# Autodesk Inventor assembly: RDS-GHN300-0000 Reagent Dosing Station
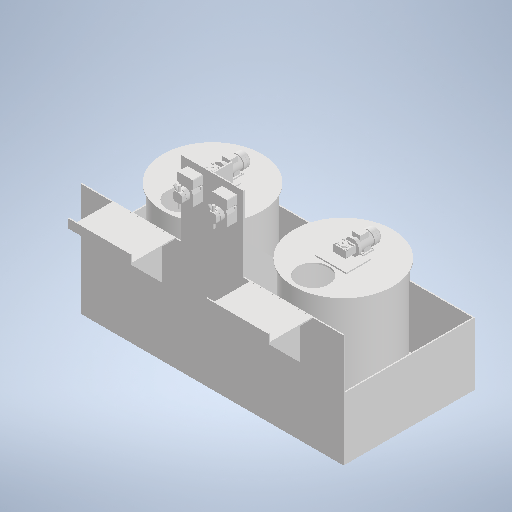
[picture p0: Inventor's stored thumbnail of the model, 512x512]
Saved by Autodesk Inventor 2026 (Build 300175000, 175)
## iProperties
Created: 2026-10-28
Part Number: RDS-GHN300-0000 Reagent Dosing Station
Document SubType Name: Assembly
Designer: user
Author: user
## Documents named in this file (6)
- C:\Users\user\Documents\Inventor\RDS-Reagent-Dosing-Station\RDS-GHN300 Reagent Dosing Station\RDS-GHN300-0000 Reagent Dosing Station.iam
- C:\Users\user\Documents\Inventor\RDS-Reagent-Dosing-Station\RDS-GHN300 Reagent Dosing Station\RDS-GHN300-1000 Container.iam
- C:\Users\user\Documents\Inventor\RDS-Reagent-Dosing-Station\RDS-GHN300 Reagent Dosing Station\RDS-GHN300-2000 Tank.ipt
- C:\Users\user\Documents\Inventor\RDS-Reagent-Dosing-Station\RDS-GHN300 Reagent Dosing Station\RDS-GHN300-2000 Tank2.ipt
- C:\Users\user\Documents\Inventor\RDS-Reagent-Dosing-Station\Старые модели\СДР 030 Дозатор реагента .ipt
- C:\Users\user\Documents\Inventor\RDS-Reagent-Dosing-Station\Старые модели\СДР 060 Мотор-редуктор 2.0.ipt
## Components (7 placed, 5 different names)
1. RDS-GHN300-1000 Container:2 [sub-assembly] — С поворотом:1, С поворотом:2, Совмещение:1, Совмещение:2, Заподлицо:3, Заподлицо:4, Заподлицо:5, Заподлицо:6
2. RDS-GHN300-2000 Tank:1 — С поворотом:1, С поворотом:3
3. RDS-GHN300-2000 Tank2:1 — С поворотом:2, С поворотом:4
4. СДР 030 Дозатор реагента :1 — Совмещение:1, Заподлицо:5, Заподлицо:6
5. СДР 030 Дозатор реагента :2 — Совмещение:2, Заподлицо:3, Заподлицо:4
6. СДР 060 Мотор-редуктор 2.0:1 — С поворотом:3
7. СДР 060 Мотор-редуктор 2.0:2 — С поворотом:4
## Relationships (10: RevoluteJoint 4, Flush 4, Mate 2)
- С поворотом:1 [RevoluteJoint]: RDS-GHN300-1000 Container:2 ↔ RDS-GHN300-2000 Tank:1
- С поворотом:2 [RevoluteJoint]: RDS-GHN300-1000 Container:2 ↔ RDS-GHN300-2000 Tank2:1
- Совмещение:1 [Mate]: RDS-GHN300-1000 Container:2 ↔ СДР 030 Дозатор реагента :1
- Совмещение:2 [Mate]: RDS-GHN300-1000 Container:2 ↔ СДР 030 Дозатор реагента :2
- Заподлицо:3 [Flush] (50 mm): RDS-GHN300-1000 Container:2 ↔ СДР 030 Дозатор реагента :2
- Заподлицо:4 [Flush] (50 mm): RDS-GHN300-1000 Container:2 ↔ СДР 030 Дозатор реагента :2
- Заподлицо:5 [Flush] (50 mm): RDS-GHN300-1000 Container:2 ↔ СДР 030 Дозатор реагента :1
- Заподлицо:6 [Flush] (50 mm): RDS-GHN300-1000 Container:2 ↔ СДР 030 Дозатор реагента :1
- С поворотом:3 [RevoluteJoint] (30 mm): RDS-GHN300-2000 Tank:1 ↔ СДР 060 Мотор-редуктор 2.0:1
- С поворотом:4 [RevoluteJoint] (30 mm): RDS-GHN300-2000 Tank2:1 ↔ СДР 060 Мотор-редуктор 2.0:2
